# Autodesk Inventor assembly: Brake caliper-W-PS1
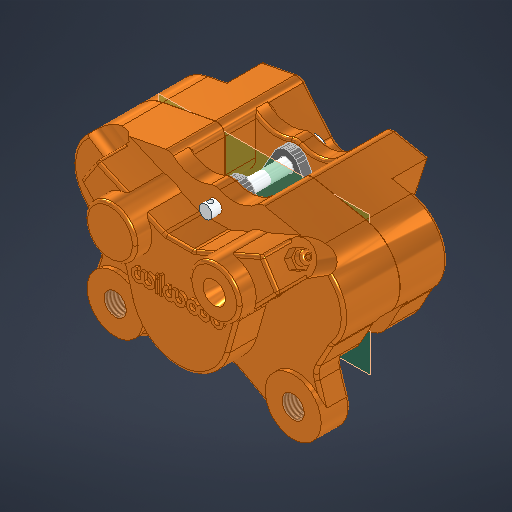
[picture p0: Inventor's stored thumbnail of the model, 512x512]
Saved by Autodesk Inventor 2026.1 (Build 301233000, 233)
## iProperties
Created: 2014-05-13
Part Number: Brake caliper-W-PS1
Description: SolidWorks IGES file using analytic representation for surfaces
Document SubType Name: Assembly
Designer: share
Sending System: SolidWorks 2013
Preprocessor: SolidWorks 2013
Minimum Resolution: 0.0
Sending System Product ID: Brake caliper-W.PS1
Receiving System Product ID: Brake caliper-W.PS1
Sent Units: Millimeter
Translation Standard: IGES 5.3
Model Creation Time: 2014-05-13
Title: C:\Users\Xubair\Downloads\ps-1-brake-caliper.snapshot.2\IGS\Brake caliper-W-PS1.IGS
Author: Xubair
## Documents named in this file (4)
- C:\Users\share\OneDrive\Documents\Personal Projects\GOGO Kart\CAD\GOGO_KART_FSAE\Suspension\Final Suspension Parts\REAL Upright\V2\Brake caliper-W-PS1.iam
- C:\Users\share\Downloads\wilwood-ps-1-brake-caliper-1.snapshot.2\IGS\Brake caliper-W-PS1\Brake caliper-W-PS1\Caliper frame.ipt
- C:\Users\share\Downloads\wilwood-ps-1-brake-caliper-1.snapshot.2\IGS\Brake caliper-W-PS1\Brake caliper-W-PS1\Brake pad.ipt
- C:\Users\share\Downloads\wilwood-ps-1-brake-caliper-1.snapshot.2\IGS\Brake caliper-W-PS1\Brake caliper-W-PS1\Brake pin.ipt
## Components (4 placed, 3 different names)
1. Caliper frame
2. Brake pad — Symmetry:1
3. Brake pad:1 — Symmetry:1
4. Brake pin
## Relationships (1: Symmetry 1)
- Symmetry:1: Brake pad ↔ Brake pad:1
